# Autodesk Inventor assembly: Parachute ejection
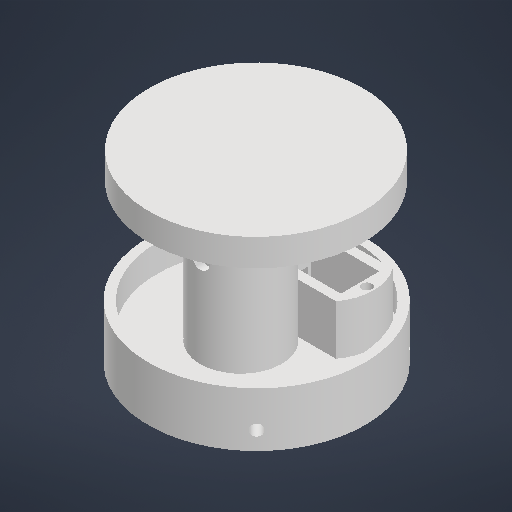
[picture p0: Inventor's stored thumbnail of the model, 512x512]
Saved by Autodesk Inventor 2027 (Build 310192060, 192F)
## iProperties
Created: 2026-10-31
Part Number: Parachute ejection
Document SubType Name: Assembly
Designer: troop
Author: troop
## Documents named in this file (3)
- C:\Users\troop\OneDrive\Documents\Inventor\SpaceX Rocket\Parachute ejection.iam
- C:\Users\troop\OneDrive\Documents\Inventor\SpaceX Rocket\Parachute Bulkhead_V3.ipt
- C:\Users\troop\OneDrive\Documents\Inventor\SpaceX Rocket\Parachute Bulkhead piston V4.ipt
## Components (2 placed, 2 different names)
1. Parachute Bulkhead_V3:1 — Mate:1
2. Parachute Bulkhead piston V4:1 — Mate:1
## Relationships (1: Mate 1)
- Mate:1: Parachute Bulkhead_V3:1 ↔ Parachute Bulkhead piston V4:1
